# Autodesk Inventor assembly: Assembly1
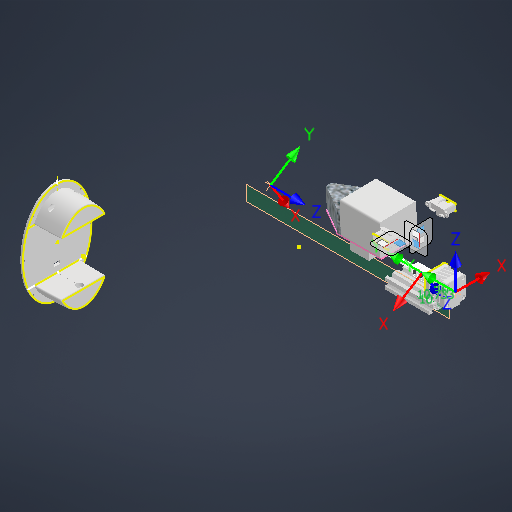
[picture p0: Inventor's stored thumbnail of the model, 512x512]
Saved by Autodesk Inventor 2027 (Build 310192060, 192F)
## iProperties
Created: 2026-06-12
Part Number: Assembly1
Document SubType Name: Assembly
Designer: thita
Author: thita
## Documents named in this file (13)
- D:\Year2\đồ án tốt nghịp\new fish\DESIGN_VIT_ME\Workgroups\new\Assembly1.iam
- D:\Year2\đồ án tốt nghịp\new fish\DESIGN_VIT_ME\Workgroups\new\DESIGN\Workgroups\NotInProject\NotInProject\DAU.ipt
- D:\Year2\đồ án tốt nghịp\new fish\DESIGN_VIT_ME\Workgroups\new\GP2Y0A02YK0F SHARP.ipt
- D:\Year2\đồ án tốt nghịp\new fish\DESIGN_VIT_ME\Workgroups\new\DESIGN\Workgroups\NotInProject\NotInProject\NAP.ipt
- D:\Year2\đồ án tốt nghịp\new fish\DESIGN_VIT_ME\Workgroups\new\Step - Nema 17 - 17HS4401S - Usongshine.ipt
- D:\Year2\đồ án tốt nghịp\new fish\DESIGN_VIT_ME\Workgroups\new\2040ALUMINIUM PROFIL 35CM_MIR.ipt
- D:\Year2\đồ án tốt nghịp\new fish\DESIGN_VIT_ME\Workgroups\new\Gia_truc_z.ipt
- D:\Year2\đồ án tốt nghịp\new fish\DESIGN_VIT_ME\Workgroups\new\5mm to 8mm rigid shaft coupler v2.ipt
- D:\Year2\đồ án tốt nghịp\new fish\DESIGN_VIT_ME\Workgroups\new\vitme-t8-buoc2.ipt
- D:\Year2\đồ án tốt nghịp\new fish\DESIGN_VIT_ME\Workgroups\new\Goi Do Dai Oc.ipt
- D:\Year2\đồ án tốt nghịp\new fish\new new new new\Workgroups\NotInProject\Pin 7.8Ah.ipt
- D:\Year2\đồ án tốt nghịp\new fish\new new new new\Workgroups\NotInProject\Ta bang inox.ipt
- D:\Year2\đồ án tốt nghịp\new fish\new new new new\Workgroups\NotInProject\MIENG SAT DE DO.ipt
## Components (13 placed, 12 different names)
1. DAU:1 — Mate:4, Mate:5, Mate:6, Mate:7, Flush:1
2. GP2Y0A02YK0F SHARP:1 — Mate:6, Mate:7
3. GP2Y0A02YK0F SHARP:2 — Mate:4, Mate:5
4. NAP:1
5. 2040ALUMINIUM PROFIL 35CM_MIR:1 — Mate:15, Mate:23, Mate:26
6. Step - Nema 17 - 17HS4401S - Usongshine:2 — Rigid:6, Rotational:2, Flush:1
7. Goi Do Dai Oc:1 — Mate:24, Mate:25, Mate:26, Flush:2, Flush:3, Flush:6
8. Gia_truc_z:1 — Rigid:6, Mate:15, Mate:23
9. 5mm to 8mm rigid shaft coupler v2:1 — Rotational:2, Rigid:7
10. vitme-t8-buoc2:1 — Rigid:7, Mate:24, Mate:25
11. Pin 7.8Ah:1 — Flush:2, Flush:3, Mate:28, Flush:4, Mate:29, Flush:5
12. Ta bang inox:1 — Mate:28, Flush:4
13. MIENG SAT DE DO:1 — Mate:29, Flush:5, Flush:6
## Relationships (20: Mate 11, Flush 6, WeldJoint 2, RevoluteJoint 1)
- Mate:4: DAU:1 ↔ GP2Y0A02YK0F SHARP:2
- Mate:5: DAU:1 ↔ GP2Y0A02YK0F SHARP:2
- Mate:6: DAU:1 ↔ GP2Y0A02YK0F SHARP:1
- Mate:7: DAU:1 ↔ GP2Y0A02YK0F SHARP:1
- Rigid:6 [WeldJoint]: Step - Nema 17 - 17HS4401S - Usongshine:2 ↔ Gia_truc_z:1
- Rotational:2 [RevoluteJoint] (-10 mm): Step - Nema 17 - 17HS4401S - Usongshine:2 ↔ 5mm to 8mm rigid shaft coupler v2:1
- Rigid:7 [WeldJoint] (-5 mm): 5mm to 8mm rigid shaft coupler v2:1 ↔ vitme-t8-buoc2:1
- Mate:15: 2040ALUMINIUM PROFIL 35CM_MIR:1 ↔ Gia_truc_z:1
- Mate:23: 2040ALUMINIUM PROFIL 35CM_MIR:1 ↔ Gia_truc_z:1
- Flush:1: DAU:1 ↔ Step - Nema 17 - 17HS4401S - Usongshine:2
- Mate:24: Goi Do Dai Oc:1 ↔ vitme-t8-buoc2:1
- Mate:25: Goi Do Dai Oc:1 ↔ vitme-t8-buoc2:1
- Mate:26 (9.328 mm): 2040ALUMINIUM PROFIL 35CM_MIR:1 ↔ Goi Do Dai Oc:1
- Flush:2 (-38 mm): Goi Do Dai Oc:1 ↔ Pin 7.8Ah:1
- Flush:3 (-19 mm): Goi Do Dai Oc:1 ↔ Pin 7.8Ah:1
- Mate:28: Pin 7.8Ah:1 ↔ Ta bang inox:1
- Flush:4 (3.2 mm): Pin 7.8Ah:1 ↔ Ta bang inox:1
- Mate:29: Pin 7.8Ah:1 ↔ MIENG SAT DE DO:1
- Flush:5: Pin 7.8Ah:1 ↔ MIENG SAT DE DO:1
- Flush:6 (-16.5 mm): Goi Do Dai Oc:1 ↔ MIENG SAT DE DO:1
## Named parameters: Finish2_Area = 9.80067, Finish3_Area = 16.8006, Finish4_Area = 23.6105, Finish5_Area = 23.6105, Finish6_Area = 1.06717
note: some values were not read from the file. Shown as the stored number, unit unknown: "Finish2_Area", "Finish3_Area", "Finish4_Area", "Finish5_Area", "Finish6_Area".
